# Autodesk Inventor assembly: LegR
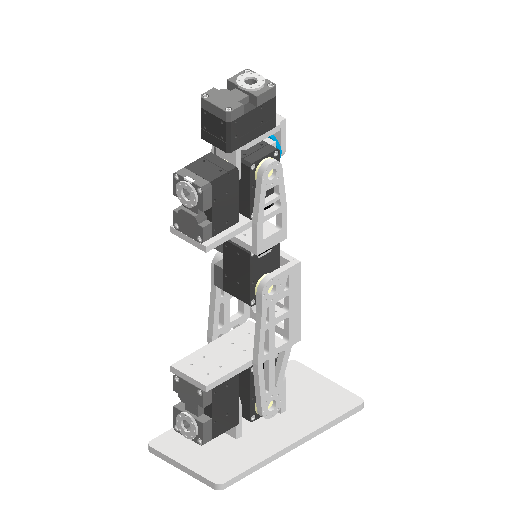
[picture p0: Inventor's stored thumbnail of the model, 512x512]
Saved by Autodesk Inventor 2025.2 (Build 292293000, 293)
## iProperties
Created: 2025-06-22
Part Number: LegR
Document SubType Name: Assembly
Designer: ricoa
Author: ricoa
## Documents named in this file (13)
- C:\Users\ricoa\Desktop\PROYEK AKHIR\project_pororo\Leg\LegR.iam
- C:\Users\ricoa\Desktop\PROYEK AKHIR\project_pororo\XM430-W350-R\XM430-W350-R\XM430-W350-RR1.iam
- C:\Users\ricoa\Desktop\PROYEK AKHIR\project_pororo\Leg\FrameBearingR.ipt
- C:\Users\ricoa\Desktop\PROYEK AKHIR\project_pororo\Leg\Pelv1R.ipt
- C:\Users\ricoa\Desktop\PROYEK AKHIR\project_pororo\Leg\PelvBracketBottomR.ipt
- C:\Users\ricoa\Desktop\PROYEK AKHIR\project_pororo\Leg\Pelv2R.ipt
- C:\Users\ricoa\Desktop\PROYEK AKHIR\project_pororo\Leg\KneeR.ipt
- C:\Users\ricoa\Desktop\PROYEK AKHIR\project_pororo\Leg\KneeSideR.ipt
- C:\Users\ricoa\Desktop\PROYEK AKHIR\project_pororo\Leg\BearingR.ipt
- C:\Users\ricoa\Desktop\PROYEK AKHIR\project_pororo\Leg\CalfSideR.ipt
- C:\Users\ricoa\Desktop\PROYEK AKHIR\project_pororo\Leg\CalfFrontR.ipt
- C:\Users\ricoa\Desktop\PROYEK AKHIR\project_pororo\Leg\FootR.ipt
- C:\Users\ricoa\Desktop\PROYEK AKHIR\project_pororo\Leg\FootStepR.ipt
## Components (24 placed, 12 different names)
1. XM430-W350-RR:1 [sub-assembly] — Mate:112, Mate:94, Mate:93
2. XM430-W350-RR:2 [sub-assembly] — Mate:64, Mate:31, Mate:30, Mate:66, Mate:65, Mate:49, Mate:113, Mate:102, Mate:101, Mate:48
3. FrameBearingR:1 — Mate:64, Mate:31, Mate:30, Mate:70, Mate:63
4. XM430-W350-RR:3 [sub-assembly] — Mate:59, Mate:58, Mate:57, Mate:115, Mate:67
5. Pelv1R:1 — Mate:59, Mate:58, Mate:57, Flush:14, Flush:13, Mate:72
6. Pelv1R:2 — Mate:115, Flush:12, Mate:71, Flush:11, Mate:62, Mate:61
7. PelvBracketBottomR:1 — Mate:67, Mate:66, Mate:65
8. Pelv2R:1 — Mate:112, Mate:94, Mate:93, Flush:14, Flush:13, Mate:72, Flush:12, Mate:71, Flush:11
9. XM430-W350-RR:4 [sub-assembly] — Mate:27, Mate:25, Flush:3, Mate:114, Mate:97, Mate:95, Mate:99, Mate:98
10. KneeR:1 — Mate:27, Mate:25, Flush:3, Mate:54, Mate:53, Mate:52, Mate:51
11. KneeSideR:1 — Mate:54, Mate:53, Mate:49
12. KneeSideR:2 — Mate:113, Mate:102, Mate:101, Mate:52, Mate:51, Mate:48
13. BearingR:1 — Mate:70, Mate:63, Mate:62, Mate:61
14. PelvBracketBottomR:2 — Mate:82, Mate:76, Mate:75, Mate:79, Mate:78, Mate:77, Mate:81, Mate:80
15. XM430-W350-RR:5 [sub-assembly] — Mate:82, Mate:76, Mate:75, Mate:116, Mate:103, Mate:100
16. XM430-W350-RR:6 [sub-assembly] — Mate:79, Mate:78, Mate:77, Mate:105, Mate:117
17. FrameBearingR:2 — Mate:81, Mate:80, Mate:74, Mate:73
18. BearingR:2 — Mate:74, Mate:73, Mate:92, Mate:91
19. CalfSideR:1 — Mate:116, Mate:114, Mate:103, Mate:100, Mate:97, Mate:95, Flush:22, Flush:20
20. CalfSideR:2 — Mate:99, Mate:98, Flush:21
21. CalfFrontR:1 — Flush:22, Flush:21, Flush:20
22. FootR:1 — Mate:105, Mate:108, Mate:110
23. FootR:2 — Mate:117, Mate:108, Mate:92, Mate:91, Mate:111, Mate:109
24. FootStepR:1 — Mate:111, Mate:110, Mate:109
## Relationships (64: Mate 57, Flush 7)
- Mate:64: XM430-W350-RR:2 ↔ FrameBearingR:1
- Mate:31: XM430-W350-RR:2 ↔ FrameBearingR:1
- Mate:30: XM430-W350-RR:2 ↔ FrameBearingR:1
- Mate:59: XM430-W350-RR:3 ↔ Pelv1R:1
- Mate:58: XM430-W350-RR:3 ↔ Pelv1R:1
- Mate:57: XM430-W350-RR:3 ↔ Pelv1R:1
- Mate:115: XM430-W350-RR:3 ↔ Pelv1R:2
- Mate:67: XM430-W350-RR:3 ↔ PelvBracketBottomR:1
- Mate:66: XM430-W350-RR:2 ↔ PelvBracketBottomR:1
- Mate:65: XM430-W350-RR:2 ↔ PelvBracketBottomR:1
- Mate:112: XM430-W350-RR:1 ↔ Pelv2R:1
- Mate:94: XM430-W350-RR:1 ↔ Pelv2R:1
- Mate:93: XM430-W350-RR:1 ↔ Pelv2R:1
- Flush:14: Pelv1R:1 ↔ Pelv2R:1
- Flush:13: Pelv1R:1 ↔ Pelv2R:1
- Mate:72: Pelv1R:1 ↔ Pelv2R:1
- Flush:12: Pelv1R:2 ↔ Pelv2R:1
- Mate:71: Pelv1R:2 ↔ Pelv2R:1
- Flush:11: Pelv1R:2 ↔ Pelv2R:1
- Mate:27: XM430-W350-RR:4 ↔ KneeR:1
- Mate:25: XM430-W350-RR:4 ↔ KneeR:1
- Flush:3 [Mate]: XM430-W350-RR:4 ↔ KneeR:1
- Mate:54: KneeR:1 ↔ KneeSideR:1
- Mate:53: KneeR:1 ↔ KneeSideR:1
- Mate:49: XM430-W350-RR:2 ↔ KneeSideR:1
- Mate:113: XM430-W350-RR:2 ↔ KneeSideR:2
- Mate:102: XM430-W350-RR:2 ↔ KneeSideR:2
- Mate:101: XM430-W350-RR:2 ↔ KneeSideR:2
- Mate:52: KneeR:1 ↔ KneeSideR:2
- Mate:51: KneeR:1 ↔ KneeSideR:2
- Mate:48: XM430-W350-RR:2 ↔ KneeSideR:2
- Mate:70: FrameBearingR:1 ↔ BearingR:1
- Mate:63: FrameBearingR:1 ↔ BearingR:1
- Mate:62: Pelv1R:2 ↔ BearingR:1
- Mate:61: Pelv1R:2 ↔ BearingR:1
- Mate:82: PelvBracketBottomR:2 ↔ XM430-W350-RR:5
- Mate:76: PelvBracketBottomR:2 ↔ XM430-W350-RR:5
- Mate:75: PelvBracketBottomR:2 ↔ XM430-W350-RR:5
- Mate:79: PelvBracketBottomR:2 ↔ XM430-W350-RR:6
- Mate:78: PelvBracketBottomR:2 ↔ XM430-W350-RR:6
- Mate:77: PelvBracketBottomR:2 ↔ XM430-W350-RR:6
- Mate:81: PelvBracketBottomR:2 ↔ FrameBearingR:2
- Mate:80: PelvBracketBottomR:2 ↔ FrameBearingR:2
- Mate:74: FrameBearingR:2 ↔ BearingR:2
- Mate:73: FrameBearingR:2 ↔ BearingR:2
- Mate:116: XM430-W350-RR:5 ↔ CalfSideR:1
- Mate:114: XM430-W350-RR:4 ↔ CalfSideR:1
- Mate:103: XM430-W350-RR:5 ↔ CalfSideR:1
- Mate:100: XM430-W350-RR:5 ↔ CalfSideR:1
- Mate:97: XM430-W350-RR:4 ↔ CalfSideR:1
- Mate:95: XM430-W350-RR:4 ↔ CalfSideR:1
- Mate:99: XM430-W350-RR:4 ↔ CalfSideR:2
- Mate:98: XM430-W350-RR:4 ↔ CalfSideR:2
- Flush:22: CalfSideR:1 ↔ CalfFrontR:1
- Flush:21: CalfSideR:2 ↔ CalfFrontR:1
- Flush:20: CalfSideR:1 ↔ CalfFrontR:1
- Mate:105: XM430-W350-RR:6 ↔ FootR:1
- Mate:117: XM430-W350-RR:6 ↔ FootR:2
- Mate:108: FootR:1 ↔ FootR:2
- Mate:92: BearingR:2 ↔ FootR:2
- Mate:91: BearingR:2 ↔ FootR:2
- Mate:111: FootR:2 ↔ FootStepR:1
- Mate:110: FootR:1 ↔ FootStepR:1
- Mate:109: FootR:2 ↔ FootStepR:1
